# Autodesk Inventor assembly: drive assembly_links
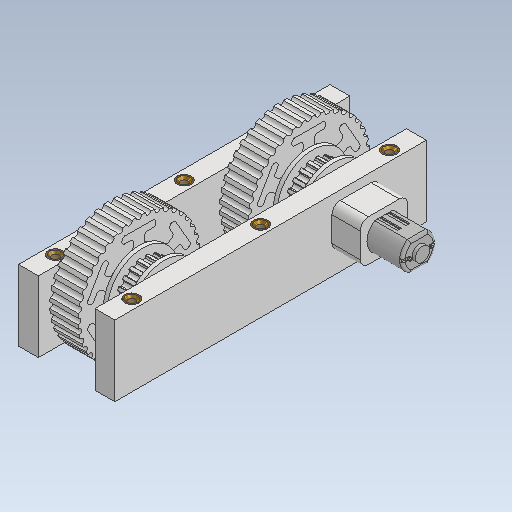
[picture p0: Inventor's stored thumbnail of the model, 512x512]
Saved by Autodesk Inventor 2026.4 (Build 304435030, 435C)
## iProperties
Created: 2026-11-20
Part Number: drive assembly_links
Document SubType Name: Assembly
Designer: weira
Author: weira
## Documents named in this file (8)
- C:\Users\weira\OneDrive\Desktop\Battlebot Projekt\Battle-Bot-Project\Version2\drive_assembly\drive assembly_links.iam
- C:\Users\weira\OneDrive\Desktop\Battlebot Projekt\Battle-Bot-Project\Version2\drive_assembly\Innneseite_links.ipt
- C:\Users\weira\OneDrive\Desktop\Battlebot Projekt\Battle-Bot-Project\Version2\drive_assembly\Außenseite_links.ipt
- C:\Users\weira\OneDrive\Desktop\Battlebot Projekt\Battle-Bot-Project\Version2\Kaufteile\N30_Gear_Motor.ipt
- C:\Users\weira\OneDrive\Desktop\Battlebot Projekt\Battle-Bot-Project\Version2\Kaufteile\689-ZZ-Kugellager.ipt
- C:\Users\weira\OneDrive\Desktop\Battlebot Projekt\Battle-Bot-Project\Version2\drive_assembly\Antriebsrad.ipt
- C:\Users\weira\OneDrive\Desktop\Battlebot Projekt\Battle-Bot-Project\Version2\drive_assembly\Rad ohne Antrieb.ipt
- C:\Users\weira\OneDrive\Desktop\Battlebot Projekt\Battle-Bot-Project\Version2\Kaufteile\Gewindemuffe m3x25.ipt
## Components (14 placed, 7 different names)
1. Innneseite_links:1 — Passend:1, Passend:2, Passend:3, Passend:8, Passend:9, Passend:22, Passend:24, Passend:26, Fluchtend:4, Fluchtend:6, Fluchtend:8, Passend:27, Passend:28, Fluchtend:9, Winkel:2, Passend:33, Passend:34
2. Außenseite_links:1 — Fluchtend:1, Passend:4, Passend:5, Passend:10, Passend:13, Winkel:1, Passend:21, Passend:23, Passend:25, Fluchtend:3, Fluchtend:5, Fluchtend:7, Passend:29, Passend:30
3. 689-ZZ-Kugellager:1 — Passend:8, Passend:9
4. 689-ZZ-Kugellager:2 — Passend:10, Passend:13, Passend:14, Passend:15
5. Rad ohne Antrieb:1 — Passend:14, Winkel:1, Passend:15
6. Gewindemuffe m3x25:1 — Passend:22, Fluchtend:8
7. Gewindemuffe m3x25:2 — Passend:24, Fluchtend:6
8. Gewindemuffe m3x25:3 — Passend:26, Fluchtend:4
9. Gewindemuffe m3x25:4 — Passend:25, Fluchtend:3
10. Gewindemuffe m3x25:5 — Passend:23, Fluchtend:5
11. Gewindemuffe m3x25:6 — Passend:21, Fluchtend:7
12. N30_Gear_Motor:1 — Passend:27, Passend:28, Fluchtend:9, Passend:33, Passend:34
13. Antriebsrad:1 — Passend:31, Passend:32, Winkel:2
14. 689-ZZ-Kugellager:3 — Passend:29, Passend:30, Passend:31, Passend:32
## Relationships (35: Mate 25, Flush 8, Angle 2)
- Passend:1 [Mate]: Innneseite_links:1
- Passend:2 [Mate]: Innneseite_links:1
- Passend:3 [Mate]: Innneseite_links:1
- Fluchtend:1 [Flush] (-20 mm): Außenseite_links:1
- Passend:4 [Mate]: Außenseite_links:1
- Passend:5 [Mate]: Außenseite_links:1
- Passend:8 [Mate]: Innneseite_links:1 ↔ 689-ZZ-Kugellager:1
- Passend:9 [Mate]: Innneseite_links:1 ↔ 689-ZZ-Kugellager:1
- Passend:10 [Mate]: Außenseite_links:1 ↔ 689-ZZ-Kugellager:2
- Passend:13 [Mate]: Außenseite_links:1 ↔ 689-ZZ-Kugellager:2
- Passend:14 [Mate]: 689-ZZ-Kugellager:2 ↔ Rad ohne Antrieb:1
- Winkel:1 [Angle] (0 deg): Außenseite_links:1 ↔ Rad ohne Antrieb:1
- Passend:15 [Mate]: 689-ZZ-Kugellager:2 ↔ Rad ohne Antrieb:1
- Passend:21 [Mate]: Außenseite_links:1 ↔ Gewindemuffe m3x25:6
- Passend:22 [Mate]: Innneseite_links:1 ↔ Gewindemuffe m3x25:1
- Passend:23 [Mate]: Außenseite_links:1 ↔ Gewindemuffe m3x25:5
- Passend:24 [Mate]: Innneseite_links:1 ↔ Gewindemuffe m3x25:2
- Passend:25 [Mate]: Außenseite_links:1 ↔ Gewindemuffe m3x25:4
- Passend:26 [Mate]: Innneseite_links:1 ↔ Gewindemuffe m3x25:3
- Fluchtend:3 [Flush]: Außenseite_links:1 ↔ Gewindemuffe m3x25:4
- Fluchtend:4 [Flush]: Innneseite_links:1 ↔ Gewindemuffe m3x25:3
- Fluchtend:5 [Flush]: Außenseite_links:1 ↔ Gewindemuffe m3x25:5
- Fluchtend:6 [Flush]: Innneseite_links:1 ↔ Gewindemuffe m3x25:2
- Fluchtend:7 [Flush]: Außenseite_links:1 ↔ Gewindemuffe m3x25:6
- Fluchtend:8 [Flush]: Innneseite_links:1 ↔ Gewindemuffe m3x25:1
- Passend:27 [Mate]: Innneseite_links:1 ↔ N30_Gear_Motor:1
- Passend:28 [Mate]: Innneseite_links:1 ↔ N30_Gear_Motor:1
- Fluchtend:9 [Flush]: Innneseite_links:1 ↔ N30_Gear_Motor:1
- Passend:29 [Mate]: Außenseite_links:1 ↔ 689-ZZ-Kugellager:3
- Passend:30 [Mate]: Außenseite_links:1 ↔ 689-ZZ-Kugellager:3
- Passend:31 [Mate]: Antriebsrad:1 ↔ 689-ZZ-Kugellager:3
- Passend:32 [Mate]: Antriebsrad:1 ↔ 689-ZZ-Kugellager:3
- Winkel:2 [Angle] (0 deg): Innneseite_links:1 ↔ Antriebsrad:1
- Passend:33 [Mate]: Innneseite_links:1 ↔ N30_Gear_Motor:1
- Passend:34 [Mate]: Innneseite_links:1 ↔ N30_Gear_Motor:1
